# Autodesk Inventor assembly: Ensamble_orquesta
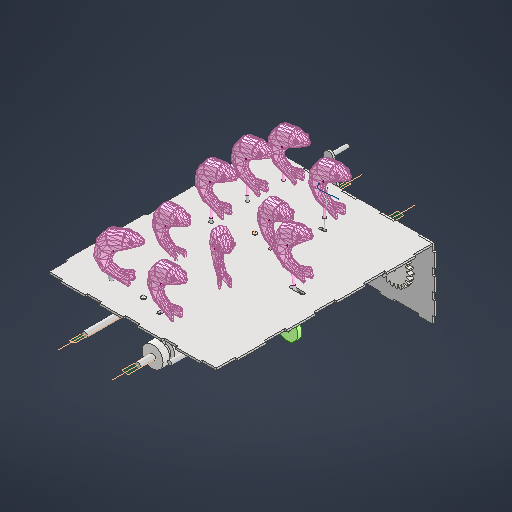
[picture p0: Inventor's stored thumbnail of the model, 512x512]
Saved by Autodesk Inventor 2027 (Build 310192000, 192)
## iProperties
Created: 2025-05-16
Part Number: Ensamble_orquesta
Document SubType Name: Assembly
Designer: laura
Author: laura
## Documents named in this file (31)
- C:\Users\laura\OneDrive - Universidad de los Andes\Documentos\Archivo Uni\7mo semestre\7mo semestre\Dinámica de Maquinaria\Taller 3\Ensamble_orquesta.iam
- C:\Users\laura\OneDrive - Universidad de los Andes\Documentos\Archivo Uni\7mo semestre\7mo semestre\Dinámica de Maquinaria\Taller 3\Tapa_orquesta.ipt
- C:\Users\laura\OneDrive - Universidad de los Andes\Documentos\Archivo Uni\7mo semestre\7mo semestre\Dinámica de Maquinaria\Taller 3\lowpolyshrimp.ipt
- C:\Users\laura\OneDrive - Universidad de los Andes\Documentos\Archivo Uni\7mo semestre\7mo semestre\Dinámica de Maquinaria\Taller 3\Lateral_derecho.ipt
- C:\Users\laura\OneDrive - Universidad de los Andes\Documentos\Archivo Uni\7mo semestre\7mo semestre\Dinámica de Maquinaria\Taller 3\eje.ipt
- C:\Users\laura\OneDrive - Universidad de los Andes\Documentos\Archivo Uni\7mo semestre\7mo semestre\Dinámica de Maquinaria\Taller 3\Disc Cam3.ipt
- C:\Users\laura\OneDrive - Universidad de los Andes\Documentos\Archivo Uni\7mo semestre\7mo semestre\Dinámica de Maquinaria\Taller 3\leva_cilindrica2.ipt
- C:\Users\laura\OneDrive - Universidad de los Andes\Documentos\Archivo Uni\7mo semestre\7mo semestre\Dinámica de Maquinaria\Taller 3\soporte_seguidor.ipt
- C:\Users\laura\OneDrive - Universidad de los Andes\Documentos\Archivo Uni\7mo semestre\7mo semestre\Dinámica de Maquinaria\Taller 3\manivela.ipt
- C:\Users\laura\OneDrive - Universidad de los Andes\Documentos\Archivo Uni\7mo semestre\7mo semestre\Dinámica de Maquinaria\Taller 3\seguidor_p2.ipt
- C:\Users\laura\OneDrive - Universidad de los Andes\Documentos\Archivo Uni\7mo semestre\7mo semestre\Dinámica de Maquinaria\Taller 3\roller.ipt
- C:\Users\laura\OneDrive - Universidad de los Andes\Documentos\Archivo Uni\7mo semestre\7mo semestre\Dinámica de Maquinaria\Taller 3\extension.ipt
- C:\Users\laura\OneDrive - Universidad de los Andes\Documentos\Archivo Uni\7mo semestre\7mo semestre\Dinámica de Maquinaria\Taller 3\eje_pq.ipt
- C:\Users\laura\OneDrive - Universidad de los Andes\Documentos\Archivo Uni\7mo semestre\7mo semestre\Dinámica de Maquinaria\Taller 3\seguidor2.ipt
- C:\Users\laura\OneDrive - Universidad de los Andes\Documentos\Archivo Uni\7mo semestre\7mo semestre\Dinámica de Maquinaria\Taller 3\extension2.ipt
- C:\Users\laura\OneDrive - Universidad de los Andes\Documentos\Archivo Uni\7mo semestre\7mo semestre\Dinámica de Maquinaria\Taller 3\Disc Cam2.ipt
- C:\Users\laura\OneDrive - Universidad de los Andes\Documentos\Archivo Uni\7mo semestre\7mo semestre\Dinámica de Maquinaria\Taller 3\a.ipt
- C:\Users\laura\OneDrive - Universidad de los Andes\Documentos\Archivo Uni\7mo semestre\7mo semestre\Dinámica de Maquinaria\Taller 3\Bracito.ipt
- C:\Users\laura\OneDrive - Universidad de los Andes\Documentos\Archivo Uni\7mo semestre\7mo semestre\Dinámica de Maquinaria\Taller 3\seguidor3.ipt
- C:\Users\laura\OneDrive - Universidad de los Andes\Documentos\Archivo Uni\7mo semestre\7mo semestre\Dinámica de Maquinaria\Taller 3\extension3.ipt
- C:\Users\laura\OneDrive - Universidad de los Andes\Documentos\Archivo Uni\7mo semestre\7mo semestre\Dinámica de Maquinaria\Taller 3\vibracion.ipt
- C:\Users\laura\OneDrive - Universidad de los Andes\Documentos\Archivo Uni\7mo semestre\7mo semestre\Dinámica de Maquinaria\Taller 3\extension4.ipt
- C:\Users\laura\OneDrive - Universidad de los Andes\Documentos\Archivo Uni\7mo semestre\7mo semestre\Dinámica de Maquinaria\Taller 3\Disc Cam5.ipt
- C:\Users\laura\OneDrive - Universidad de los Andes\Documentos\Archivo Uni\7mo semestre\7mo semestre\Dinámica de Maquinaria\Taller 3\Disc Cam6.ipt
- C:\Users\laura\OneDrive - Universidad de los Andes\Documentos\Archivo Uni\7mo semestre\7mo semestre\Dinámica de Maquinaria\Taller 3\Disc Cam7.ipt
- C:\Users\laura\OneDrive - Universidad de los Andes\Documentos\Archivo Uni\7mo semestre\7mo semestre\Dinámica de Maquinaria\Taller 3\Disc Cam8.ipt
- C:\Users\laura\OneDrive - Universidad de los Andes\Documentos\Archivo Uni\7mo semestre\7mo semestre\Dinámica de Maquinaria\Taller 3\pared1.ipt
- C:\Users\laura\OneDrive - Universidad de los Andes\Documentos\Archivo Uni\7mo semestre\7mo semestre\Dinámica de Maquinaria\Taller 3\piso.ipt
- C:\Users\laura\OneDrive - Universidad de los Andes\Documentos\Archivo Uni\7mo semestre\7mo semestre\Dinámica de Maquinaria\Taller 3\Ensamble_orquesta\Design Accelerator\Spur Gears2.iam
- C:\Users\laura\OneDrive - Universidad de los Andes\Documentos\Archivo Uni\7mo semestre\7mo semestre\Dinámica de Maquinaria\Taller 3\Ensamble_orquesta\Design Accelerator\Spur Gears4.iam
- C:\Users\laura\OneDrive - Universidad de los Andes\Documentos\Archivo Uni\7mo semestre\7mo semestre\Dinámica de Maquinaria\Taller 3\buje.ipt
## Components (59 placed, 24 different names)
1. Tapa_orquesta:1 — Mate:1, Flush:1, Flush:2, Rotational:3, Rotational:6, Mate:2, Flush:3, Flush:4, Mate:3, Flush:5, Flush:6, Rigid:1, Angle:3, Rigid:5, Mate:19, Mate:27, Mate:41, Angle:37, Mate:42, Angle:38, Angle:39, Mate:43, Flush:14, Flush:15, Mate:45, Mate:47, Rigid:38, Rigid:39
2. lowpolyshrimp:1 — Angle:5, Mate:14, Mate:15
3. lowpolyshrimp:2 — Flush:10, Rigid:3
4. lowpolyshrimp:3 — Rotational:3, Flush:13, Rigid:40
5. lowpolyshrimp:4 — Rotational:19, Angle:4
6. lowpolyshrimp:5 — Rigid:25, Mate:19, Angle:6
7. lowpolyshrimp:6 — Rotational:6
8. lowpolyshrimp:7 — Rigid:30, Mate:27
9. lowpolyshrimp:8 — Angle:39, Mate:43, Rigid:37
10. lowpolyshrimp:9 — Mate:42, Angle:38, Rigid:36
11. lowpolyshrimp:10 — Mate:41, Angle:37, Rigid:35
12. Lateral_derecho:1 — Mate:2, Flush:3, Flush:4, Mate:8, Mate:9, Rigid:21, Mate:18, Mate:37, Mate:38, Mate:39, Flush:18, Mate:68, Flush:21
13. Lateral_derecho:2 — Mate:3, Flush:5, Flush:6, Rotational:11, Rotational:12, Mate:7, Rotational:29, Flush:22
14. eje:1 — Rotational:11, Mate:11, Mate:70, Mate:73
15. Disc Cam:2 — Mate:9, Mate:11, Mate:13, Transitional:4, Mate:73
16. eje:2 — Rotational:12, Mate:5, Mate:6, Angle:1, Angle:2, Mate:16, Mate:17, Mate:24, Flush:12, Mate:69, Mate:72
17. leva_cilindrica2:1 — Mate:5, Mate:7, Angle:2, Tangent:1, Transitional:3
18. leva_cilindrica2:2 — Mate:6, Flush:7, Angle:1, Transitional:2
19. soporte_seguidor:1 — Rigid:1, Rotational:13
20. manivela:1 — Rigid:31
21. seguidor_p2:1 — Flush:8, Rotational:13, Flush:9, Rotational:14, Rigid:4
22. roller:1 — Flush:9, Rotational:14, Transitional:3
23. extension:1 — Flush:10, Rigid:3, Rigid:4
24. soporte_seguidor:2 — Rigid:5, Rotational:15
25. seguidor_p2:2 — Rotational:15, Rigid:20, Rigid:19
26. roller:2 — Rigid:20, Transitional:2
27. extension:2 — Rotational:19, Rigid:19, Angle:4
28. eje_pq:1 — Rigid:21, Mate:12, Mate:23
29. seguidor2:1 — Mate:12, Mate:13, Rigid:23, Transitional:4
30. extension2:1 — Rigid:23, Angle:5, Mate:14, Mate:15
31. Disc Cam:3 — Mate:16, Mate:17, Mate:18, Transitional:5, Mate:25
32. extension:3 — Rigid:25, Rigid:26
33. a:1 — Rigid:26, Transitional:5
34. Bracito:1
35. seguidor3:1 — Mate:23, Rigid:27, Flush:11
36. extension3:1 — Rigid:27
37. vibracion:1 — Mate:24, Mate:25, Flush:11, Flush:12
38. extension4:1 — Flush:13, Rigid:40
39. eje:3 — Rotational:29, Rigid:31, Mate:28, Mate:31, Angle:34, Mate:33, Mate:34, Mate:35, Mate:36, Mate:40, Angle:35, Angle:36, Mate:71
40. extension4:2
41. extension4:3 — Rigid:30, Mate:30, Mate:32
42. Disc Cam:2 — Mate:28, Mate:30, Mate:33
43. Disc Cam:4 — Mate:31, Mate:32, Angle:34
44. Disc Cam:2 — Mate:34, Mate:37, Mate:40
45. Disc Cam:1 — Mate:35, Mate:38, Angle:35
46. Disc Cam:1 — Mate:36, Mate:39, Angle:36
47. extension:4 — Rigid:32, Rigid:35
48. a:2 — Rigid:32
49. extension:5 — Rigid:33, Rigid:36
50. a:3 — Rigid:33
51. extension:6 — Rigid:34, Rigid:37
52. a:4 — Rigid:34
53. pared1:1 — Flush:14, Flush:15, Flush:16, Flush:17, Flush:21
54. pared1:2 — Mate:45, Mate:47, Flush:22
55. piso:1 — Flush:16, Flush:17, Flush:18
56. Spur Gears:2 [sub-assembly] — Mate:68, Mate:71, Mate:72, Flush:19, Flush:20
57. Spur Gears:3 [sub-assembly] — Mate:69, Mate:70, Flush:19, Flush:20
58. buje:1 — Rigid:38
59. buje:2 — Rigid:39
## Relationships (114: Mate 44, Flush 22, WeldJoint 22, Angle 12, RevoluteJoint 9, Transitional 4, Tangent 1)
- Mate:1: Tapa_orquesta:1
- Flush:1: Tapa_orquesta:1
- Flush:2: Tapa_orquesta:1
- Rotational:3 [RevoluteJoint]: Tapa_orquesta:1 ↔ lowpolyshrimp:3
- Rotational:6 [RevoluteJoint]: Tapa_orquesta:1 ↔ lowpolyshrimp:6
- Mate:2: Tapa_orquesta:1 ↔ Lateral_derecho:1
- Flush:3: Tapa_orquesta:1 ↔ Lateral_derecho:1
- Flush:4: Tapa_orquesta:1 ↔ Lateral_derecho:1
- Mate:3: Tapa_orquesta:1 ↔ Lateral_derecho:2
- Flush:5: Tapa_orquesta:1 ↔ Lateral_derecho:2
- Flush:6: Tapa_orquesta:1 ↔ Lateral_derecho:2
- Rotational:11 [RevoluteJoint]: Lateral_derecho:2 ↔ eje:1
- Rotational:12 [RevoluteJoint]: Lateral_derecho:2 ↔ eje:2
- Mate:5: eje:2 ↔ leva_cilindrica2:1
- Mate:6: eje:2 ↔ leva_cilindrica2:2
- Mate:7 (18.5 mm): Lateral_derecho:2 ↔ leva_cilindrica2:1
- Flush:7 (-16.5 mm): leva_cilindrica2:2
- Mate:8 (115 mm): Lateral_derecho:1
- Angle:1 (0 deg): eje:2 ↔ leva_cilindrica2:2
- Angle:2 (0 deg): eje:2 ↔ leva_cilindrica2:1
- Rigid:1 [WeldJoint]: Tapa_orquesta:1 ↔ soporte_seguidor:1
- Angle:3 (0 deg): Tapa_orquesta:1
- Tangent:1: leva_cilindrica2:1
- Flush:8: seguidor_p2:1
- Rotational:13 [RevoluteJoint]: soporte_seguidor:1 ↔ seguidor_p2:1
- Flush:9: seguidor_p2:1 ↔ roller:1
- Rotational:14 [RevoluteJoint]: seguidor_p2:1 ↔ roller:1
- Flush:10: lowpolyshrimp:2 ↔ extension:1
- Rigid:3 [WeldJoint]: lowpolyshrimp:2 ↔ extension:1
- Rigid:4 [WeldJoint]: seguidor_p2:1 ↔ extension:1
- Rigid:5 [WeldJoint]: Tapa_orquesta:1 ↔ soporte_seguidor:2
- Rotational:15 [RevoluteJoint]: soporte_seguidor:2 ↔ seguidor_p2:2
- Rigid:20 [WeldJoint]: seguidor_p2:2 ↔ roller:2
- Rotational:19 [RevoluteJoint]: lowpolyshrimp:4 ↔ extension:2
- Rigid:19 [WeldJoint]: seguidor_p2:2 ↔ extension:2
- Transitional:2: leva_cilindrica2:2 ↔ roller:2
- Angle:4 (0 deg): lowpolyshrimp:4 ↔ extension:2
- Mate:9 (158 mm): Lateral_derecho:1 ↔ Disc Cam:2
- Transitional:3: leva_cilindrica2:1 ↔ roller:1
- Rigid:21 [WeldJoint]: Lateral_derecho:1 ↔ eje_pq:1
- Mate:11: eje:1 ↔ Disc Cam:2
- Mate:12: eje_pq:1 ↔ seguidor2:1
- Mate:13 (8 mm): Disc Cam:2 ↔ seguidor2:1
- Rigid:23 [WeldJoint]: seguidor2:1 ↔ extension2:1
- Angle:5 (180 deg): lowpolyshrimp:1 ↔ extension2:1
- Mate:14: lowpolyshrimp:1 ↔ extension2:1
- Mate:15: lowpolyshrimp:1 ↔ extension2:1
- Transitional:4: Disc Cam:2 ↔ seguidor2:1
- Mate:16: eje:2 ↔ Disc Cam:3
- Mate:17: eje:2 ↔ Disc Cam:3
- Mate:18 (48 mm): Lateral_derecho:1 ↔ Disc Cam:3
- Rigid:25 [WeldJoint]: lowpolyshrimp:5 ↔ extension:3
- Mate:19: Tapa_orquesta:1 ↔ lowpolyshrimp:5
- Rigid:26 [WeldJoint]: extension:3 ↔ a:1
- Angle:6 (0 deg): lowpolyshrimp:5
- Mate:23: eje_pq:1 ↔ seguidor3:1
- Rigid:27 [WeldJoint]: seguidor3:1 ↔ extension3:1
- Transitional:5: Disc Cam:3 ↔ a:1
- Mate:24: eje:2 ↔ vibracion:1
- Mate:25 (10 mm): Disc Cam:3 ↔ vibracion:1
- Flush:11: seguidor3:1 ↔ vibracion:1
- Flush:12: eje:2 ↔ vibracion:1
- Flush:13: lowpolyshrimp:3 ↔ extension4:1
- Rotational:29 [RevoluteJoint]: Lateral_derecho:2 ↔ eje:3
- Rigid:30 [WeldJoint]: lowpolyshrimp:7 ↔ extension4:3
- Mate:27: Tapa_orquesta:1 ↔ lowpolyshrimp:7
- Rigid:31 [WeldJoint]: manivela:1 ↔ eje:3
- Mate:28: eje:3 ↔ Disc Cam:2
- Mate:30 (13 mm): extension4:3 ↔ Disc Cam:2
- Mate:31: eje:3 ↔ Disc Cam:4
- Mate:32 (-8 mm): extension4:3 ↔ Disc Cam:4
- Angle:34 (0 deg): eje:3 ↔ Disc Cam:4
- Mate:33: eje:3 ↔ Disc Cam:2
- Mate:34: eje:3 ↔ Disc Cam:2
- Mate:35: eje:3 ↔ Disc Cam:1
- Mate:36: eje:3 ↔ Disc Cam:1
- Mate:37 (25 mm): Lateral_derecho:1 ↔ Disc Cam:2
- Mate:38 (77 mm): Lateral_derecho:1 ↔ Disc Cam:1
- Mate:39 (129 mm): Lateral_derecho:1 ↔ Disc Cam:1
- Mate:40: eje:3 ↔ Disc Cam:2
- Angle:35 (60 deg): eje:3 ↔ Disc Cam:1
- Angle:36 (0 deg): eje:3 ↔ Disc Cam:1
- Mate:41: Tapa_orquesta:1 ↔ lowpolyshrimp:10
- Angle:37 (180 deg): Tapa_orquesta:1 ↔ lowpolyshrimp:10
- Mate:42: Tapa_orquesta:1 ↔ lowpolyshrimp:9
- Angle:38 (180 deg): Tapa_orquesta:1 ↔ lowpolyshrimp:9
- Angle:39 (180 deg): Tapa_orquesta:1 ↔ lowpolyshrimp:8
- Mate:43: Tapa_orquesta:1 ↔ lowpolyshrimp:8
- Rigid:32 [WeldJoint]: extension:4 ↔ a:2
- Rigid:33 [WeldJoint]: extension:5 ↔ a:3
- Rigid:34 [WeldJoint]: extension:6 ↔ a:4
- Rigid:35 [WeldJoint]: lowpolyshrimp:10 ↔ extension:4
- Rigid:36 [WeldJoint]: lowpolyshrimp:9 ↔ extension:5
- Rigid:37 [WeldJoint]: lowpolyshrimp:8 ↔ extension:6
- Flush:14: Tapa_orquesta:1 ↔ pared1:1
- Flush:15: Tapa_orquesta:1 ↔ pared1:1
- Mate:45: Tapa_orquesta:1 ↔ pared1:2
- Mate:47: Tapa_orquesta:1 ↔ pared1:2
- Flush:16: pared1:1 ↔ piso:1
- Flush:17: pared1:1 ↔ piso:1
- Flush:18: Lateral_derecho:1 ↔ piso:1
- Mate:68: Lateral_derecho:1 ↔ Spur Gears:2
- Mate:69: eje:2 ↔ Spur Gears:3
- Mate:70: eje:1 ↔ Spur Gears:3
- Mate:71: eje:3 ↔ Spur Gears:2
- Mate:72: eje:2 ↔ Spur Gears:2
- Flush:19: Spur Gears:2 ↔ Spur Gears:3
- Flush:20: Spur Gears:2 ↔ Spur Gears:3
- Rigid:38 [WeldJoint]: Tapa_orquesta:1 ↔ buje:1
- Rigid:39 [WeldJoint]: Tapa_orquesta:1 ↔ buje:2
- Rigid:40 [WeldJoint]: lowpolyshrimp:3 ↔ extension4:1
- Mate:73: eje:1 ↔ Disc Cam:2
- Flush:21: Lateral_derecho:1 ↔ pared1:1
- Flush:22: Lateral_derecho:2 ↔ pared1:2
## Named parameters: ancho = 220 mm, largo = 310 mm, d_fila1 = 40 mm, d_fila2 = 10 mm, d_fila3 = 66 mm, d_eje = 8 mm, alto = 100 mm
